# Autodesk Inventor assembly: Baugruppe1
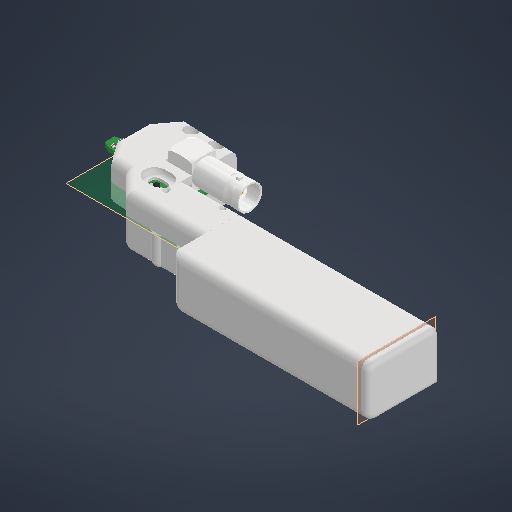
[picture p0: Inventor's stored thumbnail of the model, 512x512]
Saved by Autodesk Inventor 2026.2 (Build 302298000, 298)
## iProperties
Created: 2026-10-14
Part Number: Baugruppe1
Document SubType Name: Assembly
Designer: leo
Author: leo
## Documents named in this file (6)
- C:\Users\leo\OneDrive\dokumente\16_2_Inventor_bach_2\Baugruppe1.iam
- C:\Users\leo\OneDrive\dokumente\16_2_Inventor_bach_2\diff_probe_v2\diff_probe_v2\diff_probe_v2.iam
- C:\Users\leo\OneDrive\dokumente\16_2_Inventor_bach_2\case1.ipt
- C:\Users\leo\OneDrive\dokumente\16_2_Inventor_bach_2\case2.ipt
- C:\Users\leo\OneDrive\dokumente\16_2_Inventor_bach_2\case3.ipt
- C:\Users\leo\OneDrive\dokumente\16_2_Inventor_bach_2\case4.ipt
## Components (5 placed, 5 different names)
1. diff_probe_v2:1 [sub-assembly] — Fluchtend:1, Fluchtend:2, Fluchtend:3
2. case1:1 — Fluchtend:1, Fluchtend:2, Fluchtend:4
3. case2:1 — Fluchtend:3, Fluchtend:4, Fluchtend:5, Fluchtend:6
4. case3:1 — Fluchtend:5, Fluchtend:6, Fluchtend:7, Fluchtend:8
5. case4:1 — Fluchtend:7, Fluchtend:8
## Relationships (8: Flush 8)
- Fluchtend:1 [Flush]: diff_probe_v2:1 ↔ case1:1
- Fluchtend:2 [Flush]: diff_probe_v2:1 ↔ case1:1
- Fluchtend:3 [Flush]: diff_probe_v2:1 ↔ case2:1
- Fluchtend:4 [Flush]: case1:1 ↔ case2:1
- Fluchtend:5 [Flush]: case2:1 ↔ case3:1
- Fluchtend:6 [Flush]: case2:1 ↔ case3:1
- Fluchtend:7 [Flush]: case3:1 ↔ case4:1
- Fluchtend:8 [Flush]: case3:1 ↔ case4:1
